# Autodesk Inventor assembly: AssemblyPendulum2
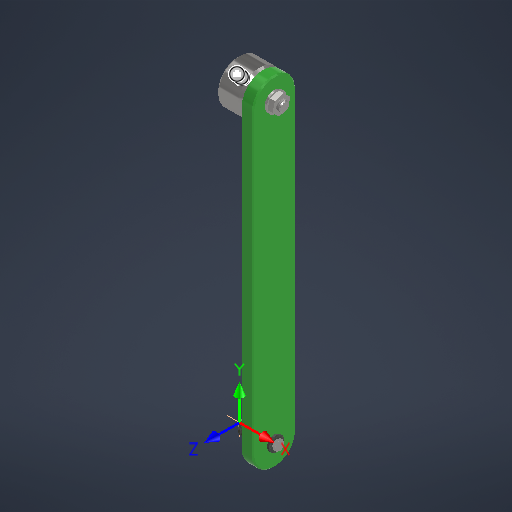
[picture p0: Inventor's stored thumbnail of the model, 512x512]
Saved by Autodesk Inventor 2027.1 (Build 311270010, 270A)
## iProperties
Created: 2026-10-15
Part Number: AssemblyPendulum2
Document SubType Name: Assembly
Designer: lucao
Author: lucao
## Documents named in this file (10)
- C:\Users\lucao\Desktop\RL-Rotary-Inverted-Double-Pendulum\CAD\AssemblyPendulum2.iam
- C:\Users\lucao\Desktop\RL-Rotary-Inverted-Double-Pendulum\CAD\pendulum_2.ipt
- C:\Users\lucao\Desktop\RL-Rotary-Inverted-Double-Pendulum\CAD\rod_link1to2.ipt
- C:\Users\lucao\Documents\Inventor\Content Center Files\R2027\en-US\DIN 7349\DIN 7349 - 4,3.ipt
- C:\Users\lucao\Documents\Inventor\Content Center Files\R2027\en-US\CSN EN 24017\ISO 4017 - M4 x 8CSN EN.ipt
- C:\Users\lucao\Desktop\RL-Rotary-Inverted-Double-Pendulum\CAD\magnet.ipt
- C:\Users\lucao\Documents\Inventor\Content Center Files\R2027\en-US\DIN EN ISO 7091\DIN EN ISO 7091 - 8.ipt
- C:\Users\lucao\Documents\Inventor\Content Center Files\R2027\en-US\DIN 7984\DIN 7984 - M8 x 40.ipt
- C:\Users\lucao\Documents\Inventor\Content Center Files\R2027\en-US\DIN EN 24 036(2)\DIN EN 24 036 - M8.ipt
- C:\Users\lucao\Desktop\RL-Rotary-Inverted-Double-Pendulum\CAD\weight_arm2.ipt
## Components (12 placed, 9 different names)
1. pendulum_2:1 — Mate:16
2. rod_link1to2:1 — Mate:11
3. DIN 7349 4,3:1 — Mate:11
4. DIN 7349 4,3:2
5. CSN EN 24017 M4 x 8:1
6. CSN EN 24017 M4 x 8:2
7. magnet:1 — Mate:14, Mate:15
8. DIN EN ISO 7091 8:1 — Mate:12
9. DIN EN ISO 7091 8:2
10. DIN 7984 M8 x 40:1 — Mate:13
11. DIN EN 24036 M8:1
12. weight_arm2:1 — Mate:12, Mate:13
## Relationships (21: Mate 16, Insert 4, Flush 1)
- [Mate]: pendulum_2:1 ↔ rod_link1to2:1
- [Flush]: pendulum_2:1 ↔ rod_link1to2:1
- [Mate]: rod_link1to2:1 ↔ DIN 7349 4,3:1
- [Mate]: rod_link1to2:1 ↔ DIN 7349 4,3:2
- [Mate]: pendulum_2:1 ↔ DIN 7349 4,3:2
- [Insert]: DIN 7349 4,3:1 ↔ CSN EN 24017 M4 x 8:1
- [Mate]: rod_link1to2:1 ↔ CSN EN 24017 M4 x 8:2
- [Mate]: DIN 7349 4,3:2 ↔ CSN EN 24017 M4 x 8:2
- [Mate]: CSN EN 24017 M4 x 8:1 ↔ magnet:1
- [Mate]: DIN 7349 4,3:1 ↔ magnet:1
- [Insert]: pendulum_2:1 ↔ DIN EN ISO 7091 8:2
- [Insert]: DIN EN ISO 7091 8:1 ↔ DIN 7984 M8 x 40:1
- [Insert]: DIN EN ISO 7091 8:2 ↔ DIN EN 24036 M8:1
- [Mate]: pendulum_2:1 ↔ weight_arm2:1
- [Mate]: pendulum_2:1 ↔ weight_arm2:1
- Mate:11: rod_link1to2:1 ↔ DIN 7349 4,3:1
- Mate:12: DIN EN ISO 7091 8:1 ↔ weight_arm2:1
- Mate:13: DIN 7984 M8 x 40:1 ↔ weight_arm2:1
- Mate:14: magnet:1
- Mate:15: magnet:1
- Mate:16: pendulum_2:1
